# Autodesk Inventor assembly: 三脚架装配
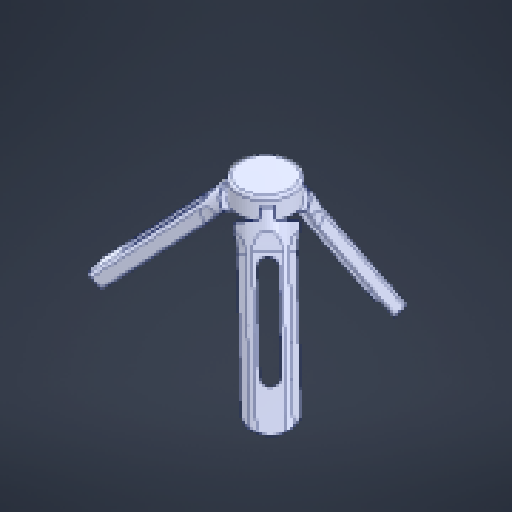
[picture p0: Inventor's stored thumbnail of the model, 512x512]
Saved by Autodesk Inventor 2025 (Build 290162000, 162)
## iProperties
Created: 2025-10-21
Part Number: 三脚架装配
Document SubType Name: Assembly
Designer: HZD
Author: HZD
## Documents named in this file (4)
- D:\2 B Mechanical design\Bright\三脚架\三脚架装配.iam
- D:\2 B Mechanical design\Bright\三脚架\零件5.ipt
- D:\2 B Mechanical design\Bright\三脚架\零件9.ipt
- D:\2 B Mechanical design\Bright\三脚架\零件10.ipt
## Components (5 placed, 3 different names)
1. 零件5:1 — 配合:1, 配合:2
2. 零件9:1 — 配合:7, 配合:8, 配合:9
3. 零件10:1 — 配合:1, 配合:2, 配合:3, 配合:4, 配合:5, 配合:6, 配合:7, 配合:8, 配合:9
4. 零件5:2 — 配合:3, 配合:4
5. 零件5:3 — 配合:5, 配合:6
## Relationships (9: Mate 9)
- 配合:1 [Mate]: 零件5:1 ↔ 零件10:1
- 配合:2 [Mate]: 零件5:1 ↔ 零件10:1
- 配合:3 [Mate]: 零件10:1 ↔ 零件5:2
- 配合:4 [Mate]: 零件10:1 ↔ 零件5:2
- 配合:5 [Mate]: 零件10:1 ↔ 零件5:3
- 配合:6 [Mate]: 零件10:1 ↔ 零件5:3
- 配合:7 [Mate]: 零件9:1 ↔ 零件10:1
- 配合:8 [Mate]: 零件9:1 ↔ 零件10:1
- 配合:9 [Mate]: 零件9:1 ↔ 零件10:1
